# Autodesk Inventor assembly: ArmAssembly1
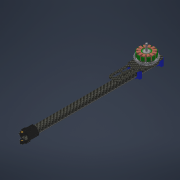
[picture p0: Inventor's stored thumbnail of the model, 180x180]
Saved by Autodesk Inventor 2021 (Build 250183000, 183)
## iProperties
Created: 2021-05-23
Part Number: ArmAssembly1
Document SubType Name: Assembly
Designer: Administrator
Title: ArmAssembly1 v1
Author: Administrator
## Documents named in this file (8)
- D:\Experimen\Inventor\BAYUCARAKA\Tarot\ArmAssembly\ArmAssembly1.iam
- D:\Experimen\Inventor\BAYUCARAKA\Tarot\ArmAssembly\CarbonArm.ipt
- D:\Experimen\Inventor\BAYUCARAKA\Tarot\ArmAssembly\ArmCopterAttachement.ipt
- D:\Experimen\Inventor\BAYUCARAKA\Tarot\ArmAssembly\Motortoarmattachement.ipt
- D:\Experimen\Inventor\BAYUCARAKA\Tarot\ArmAssembly\Lowerclamp.ipt
- D:\Experimen\Inventor\BAYUCARAKA\Tarot\ArmAssembly\Upperclamp.ipt
- D:\Experimen\Inventor\BAYUCARAKA\Tarot\Arm Pivot\20021-004_arm-pivot.iam
- D:\Experimen\Inventor\BAYUCARAKA\Tarot\MN 3508\3508_low_res.iam
## Components (9 placed, 7 different names)
1. CarbonArm:1 — Mate:1, Mate:2, Mate:3
2. ArmCopterAttachement:1
3. Motortoarmattachement:1 — Mate:4, Mate:5, Mate:6
4. Lowerclamp:1
5. Upperclamp:1
6. Lowerclamp:2
7. Upperclamp:2
8. 20021-004_arm-pivot:1 [sub-assembly] — Mate:1, Mate:2, Mate:3
9. 3508_low_res:1 [sub-assembly] — Mate:4, Mate:5, Mate:6
## Relationships (6: Mate 6)
- Mate:1: CarbonArm:1 ↔ 20021-004_arm-pivot:1
- Mate:2: CarbonArm:1 ↔ 20021-004_arm-pivot:1
- Mate:3: CarbonArm:1 ↔ 20021-004_arm-pivot:1
- Mate:4: Motortoarmattachement:1 ↔ 3508_low_res:1
- Mate:5: Motortoarmattachement:1 ↔ 3508_low_res:1
- Mate:6: Motortoarmattachement:1 ↔ 3508_low_res:1
